# Autodesk Inventor assembly: gear_box
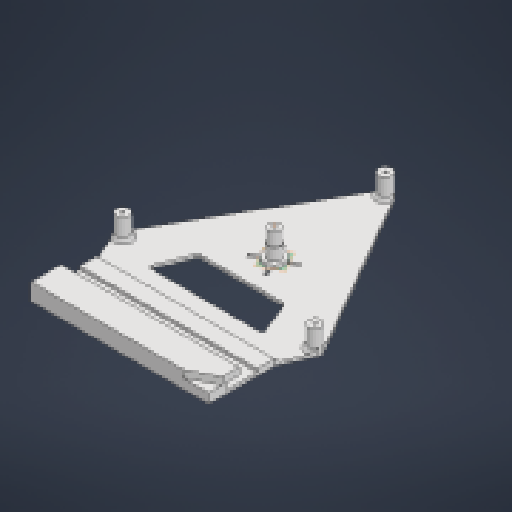
[picture p0: Inventor's stored thumbnail of the model, 512x512]
Saved by Autodesk Inventor 2027.1 (Build 311270010, 270A)
## iProperties
Created: 2025-09-25
Part Number: gear_box
Document SubType Name: Assembly
Designer: hibik
Author: hibik
## Documents named in this file (4)
- D:\model\D2_Conveyor_2026\power_module\Paradox Planetary Gear Reducer\gear_box.iam
- D:\model\D2_Conveyor_2026\power_module\Paradox Planetary Gear Reducer\Rail.ipt
- D:\model\D2_Conveyor_2026\power_module\Paradox Planetary Gear Reducer\Shaft.ipt
- D:\model\D2_Conveyor_2026\power_module\Paradox Planetary Gear Reducer\Bearings\6200ZZNR.ipt
## Components (3 placed, 3 different names)
1. Rail:1 — 角度:1, リジッド:1
2. Shaft:1 — リジッド:1, 回転:1
3. 6200ZZNR:1 — 回転:1
## Relationships (5: Mate 2, Angle 1, WeldJoint 1, RevoluteJoint 1)
- メイト:11 [Mate]
- メイト:12 [Mate]
- 角度:1 [Angle] (0 deg): Rail:1
- リジッド:1 [WeldJoint]: Rail:1 ↔ Shaft:1
- 回転:1 [RevoluteJoint]: Shaft:1 ↔ 6200ZZNR:1
